# Autodesk Inventor assembly: joint-flip
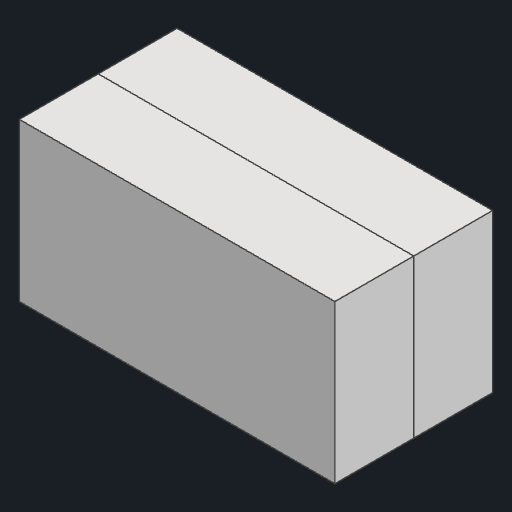
[picture p0: Inventor's stored thumbnail of the model, 512x512]
Saved by Autodesk Inventor 2026.1 (Build 301233000, 233)
## iProperties
Created: 2026-10-30
Part Number: joint-flip
Document SubType Name: Assembly
Designer: anony
Author: anony
## Documents named in this file (2)
- C:\Users\anony\OneDrive\Desktop\AI Projects\CAD Convert\corpus\generated\asm\joint-flip.iam
- C:\Users\anony\OneDrive\Desktop\AI Projects\CAD Convert\corpus\generated\asmparts\box.ipt
## Components (2 placed, 1 different names)
1. box:1 — Rigid:1
2. box:2 — Rigid:1
## Relationships (1: WeldJoint 1)
- Rigid:1 [WeldJoint]: box:1 ↔ box:2
